# Autodesk Inventor assembly: MM0948AN140_G00_805
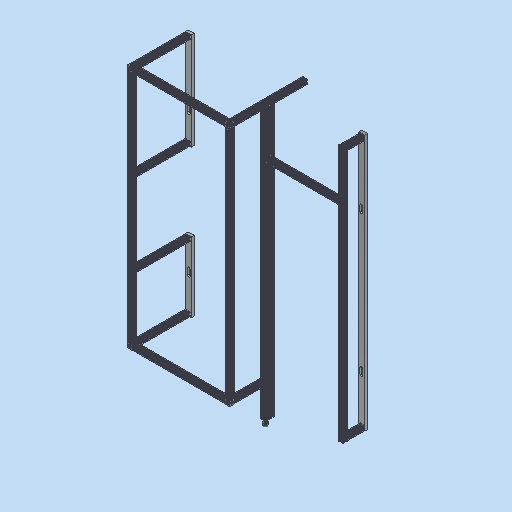
[picture p0: Inventor's stored thumbnail of the model, 512x512]
Saved by Autodesk Inventor 2023.3 (Build 273359000, 359)
## iProperties
RuleStatus: InUse
Created: 2023-03-23
Part Number: MM0948AN140_G00_805
Description: =<RBPARTNOTITLE2>
Document SubType Name: Assembly
Designer: FH/Wi
Mass: 4741.17 g
Surface Area: 15490.5 cm^2
Volume: 1790.95 cm^3
Density: 2.6473 g/cm^3
AnP_Kategorie: 98
AnP_Material: =<Material>
AnP_TemplVers: 20200821
RBDOCUMENTTYPE: DRF
RBDOCUMENTVERSION: 00
RBDRAWINGMAINSCALE: 1:1
RBDRAWINGMISSINGSPEC: --
RBDRAWINGVOLUME: --
RBDSV1: 0850
RBGBEDGESIN1: +0,5
RBGBEDGESIN2: +0,2
RBGBEDGESOUT1: -0,3
RBGBEDGESOUT2: -0,1
RBMATERIAL: =<Material>
RBMATMEETS: --
RBMATNO: =<Part Number>
RBPARTMADEOF: --
RBPARTNO: SIEHE MNR
RBPARTNOTITLE1: enter description here
RBPARTNOTITLE2: hier Bezeichnung eintragen
RBPARTSAFETYINDICATOR: --
RBSURFACE: --
RBSURFACE2: --
RBZEDGESNORM: ISO13715:2002-06
RBZGENDIMCLASS: m
RBZGENDIMNORM: ISO 2768-1:1989-11
RBZGENGEOCLASS: H
RBZGENGEONORM: ISO 2768-2:1989-11
RBZSURFACENORM: ISO13D2:2002-02
RBZTOLERANCENORM: ISO 14405-1:2010-12
Author: FH/Wi
Keywords: =<RBPARTMADEOF>
Comments: =<RBSURFACE2>
Revision Number: 01
## Documents named in this file (17)
- C:\Users\rea9an\Documents\Inventor\TCAI2412_te1910_EM\AS00000954.iam
- C:\Users\rea9an\Documents\Inventor\TCAI2412_te1910_EM\PT00004339.ipt
- C:\Users\rea9an\Documents\Inventor\TCAI2412_te1910_EM\PT00004322.ipt
- C:\Users\rea9an\Documents\Inventor\TCAI2412_te1910_EM\PT00004293.ipt
- C:\Users\rea9an\Documents\Inventor\TCAI2412_te1910_EM\PT00004351.ipt
- C:\Users\rea9an\Documents\Inventor\TCAI2412_te1910_EM\PT00004354.ipt
- C:\Users\rea9an\Documents\Inventor\TCAI2412_te1910_EM\PT00004314.ipt
- C:\Users\rea9an\Documents\Inventor\TCAI2412_te1910_EM\PT00004342.ipt
- C:\Users\rea9an\Documents\Inventor\TCAI2412_te1910_EM\PT00004353.ipt
- C:\Users\rea9an\Documents\Inventor\TCAI2412_te1910_EM\PT00004345.ipt
- C:\Users\rea9an\Documents\Inventor\TCAI2412_te1910_EM\PT00004676.ipt
- C:\Users\rea9an\Documents\Inventor\TCAI2412_te1910_EM\PT00004349.ipt
- C:\Users\rea9an\Documents\Inventor\TCAI2412_te1910_EM\PT00004677.ipt
- C:\Users\rea9an\Documents\Inventor\TCAI2412_te1910_EM\PT00004678.ipt
- C:\Users\rea9an\Documents\Inventor\TCAI2412_te1910_EM\PT00004352.ipt
- C:\Users\rea9an\Documents\Inventor\TCAI2412_te1910_EM\PT00004887.ipt
- C:\Users\rea9an\Documents\Inventor\TCAI2412_te1910_EM\PT00004346.ipt
## Components (45 placed, 16 different names)
1. PT00004676:1 — Fluchtend:83, Fluchtend:84, Fluchtend:86, Fluchtend:87, Fluchtend:94, Fluchtend:95, Einfügen:6, Einfügen:7
2. PT00004677:1 — Fluchtend:84, Fluchtend:85, Fluchtend:88, Fluchtend:89, Fluchtend:96, Fluchtend:97, Passend:58, Passend:59, Fluchtend:99, Einfügen:4, Einfügen:5
3. PT00004678:1 — Fluchtend:85, Fluchtend:90, Fluchtend:105, Einfügen:2, Einfügen:3
4. PT00004322:4 — Passend:15, Fluchtend:15, Fluchtend:47, Fluchtend:88, Fluchtend:89, Fluchtend:98
5. PT00004322:3 — Fluchtend:30, Passend:31, Fluchtend:43, Fluchtend:44
6. PT00004322:1 — Fluchtend:72
7. PT00004322:2 — Fluchtend:21, Fluchtend:22, Fluchtend:35, Fluchtend:86, Passend:56, Fluchtend:92, Fluchtend:93
8. PT00004293:1 — Passend:22, Passend:43
9. PT00004339:1 — Passend:15, Fluchtend:15, Fluchtend:21, Fluchtend:22, Fluchtend:47, Fluchtend:87, Passend:55, Passend:57
10. PT00004339:2 — Fluchtend:30
11. PT00004351:1 — Passend:31, Fluchtend:43, Fluchtend:44, Passend:42, Passend:44, Passend:45
12. PT00004353:1 — Fluchtend:73, Passend:52
13. PT00004354:1 — Passend:42, Passend:43
14. PT00004345:1 — Fluchtend:73, Fluchtend:74, Passend:52, Fluchtend:90, Fluchtend:102, Fluchtend:103, Passend:60, Fluchtend:105, Fluchtend:106, Passend:61, Fluchtend:107
15. PT00004342:1
16. PT00004349:1 — Passend:56, Fluchtend:92, Fluchtend:93
17. PT00004349:2 — Fluchtend:94, Passend:57, Fluchtend:95
18. PT00004349:3 — Fluchtend:96, Fluchtend:97, Passend:58
19. PT00004349:5 — Fluchtend:98, Passend:59, Fluchtend:99
20. PT00004346:1
21. PT00004342:2
22. PT00004352:1 — Fluchtend:102, Fluchtend:103, Passend:60
23. PT00004352:2 — Fluchtend:106, Passend:61, Fluchtend:107
24. PT00004887:1 — Einfügen:2
25. PT00004887:2 — Einfügen:3
26. PT00004887:3 — Einfügen:4
27. PT00004887:4 — Einfügen:5
28. PT00004887:5 — Einfügen:6
29. PT00004887:6 — Einfügen:7
30. PT00004314:1 — Passend:44, Passend:45
31. PT00004314:2
32. PT00004314:3
33. PT00004314:4
34. PT00004314:5
35. PT00004314:6
36. PT00004314:7
37. PT00004314:8
38. PT00004314:9
39. PT00004314:10
40. PT00004314:11
41. PT00004314:12
42. PT00004314:13
43. PT00004314:14
44. PT00004314:15
45. PT00004314:16
## Component patterns: (16 elements, first: PT00004314:1)
## Relationships (76: Flush 45, Mate 23, Insert 7, Angle 1)
- [Mate]: PT00004322:2 ↔ PT00004339:1
- [Mate]: PT00004322:1 ↔ PT00004346:1
- Passend:15 [Mate]: PT00004322:4 ↔ PT00004339:1
- Fluchtend:15 [Flush]: PT00004322:4 ↔ PT00004339:1
- [Flush]: PT00004322:1 ↔ PT00004339:2
- [Flush]: PT00004322:1 ↔ PT00004339:2
- [Mate]: PT00004322:1 ↔ PT00004339:2
- [Insert]: PT00004322:3 ↔ PT00004339:2
- [Flush]: PT00004339:1 ↔ PT00004342:1
- [Flush]: PT00004322:2 ↔ PT00004342:1
- Fluchtend:21 [Flush]: PT00004322:2 ↔ PT00004339:1
- [Mate]: PT00004322:2 ↔ PT00004342:1
- Fluchtend:22 [Flush]: PT00004322:2 ↔ PT00004339:1
- [Flush]: PT00004322:1 ↔ PT00004342:1
- [Flush]: PT00004322:1 ↔ PT00004342:1
- Fluchtend:30 [Flush]: PT00004322:3 ↔ PT00004339:2
- Passend:22 [Mate]: PT00004293:1
- [Angle] (0 deg): PT00004293:1 ↔ PT00004354:1
- [Mate] (-1855 mm): PT00004342:1
- Fluchtend:35 [Flush] (1153 mm): PT00004322:2
- [Flush]: PT00004322:4 ↔ PT00004342:2
- [Flush]: PT00004322:1 ↔ PT00004346:1
- [Flush]: PT00004322:1 ↔ PT00004346:1
- Passend:31 [Mate]: PT00004322:3 ↔ PT00004351:1
- Fluchtend:43 [Flush]: PT00004322:3 ↔ PT00004351:1
- Fluchtend:44 [Flush]: PT00004322:3 ↔ PT00004351:1
- Fluchtend:47 [Flush]: PT00004322:4 ↔ PT00004339:1
- [Mate]: PT00004322:4 ↔ PT00004342:2
- [Flush]: PT00004322:4 ↔ PT00004342:2
- [Mate] (941 mm): PT00004353:1
- [Mate]: PT00004354:1 ↔ PT00004346:1
- [Flush]: PT00004354:1 ↔ PT00004346:1
- Passend:42 [Mate]: PT00004351:1 ↔ PT00004354:1
- Passend:43 [Mate]: PT00004293:1 ↔ PT00004354:1
- Passend:44 [Mate]: PT00004351:1 ↔ PT00004314:1
- Passend:45 [Mate]: PT00004351:1 ↔ PT00004314:1
- [Flush]: PT00004353:1 ↔ PT00004354:1
- Fluchtend:72 [Flush] (51 mm): PT00004322:1
- Fluchtend:73 [Flush]: PT00004353:1 ↔ PT00004345:1
- Fluchtend:74 [Flush] (370 mm): PT00004345:1
- Passend:52 [Mate]: PT00004353:1 ↔ PT00004345:1
- Fluchtend:83 [Flush] (1605 mm): PT00004676:1
- Fluchtend:84 [Flush]: PT00004676:1 ↔ PT00004677:1
- Fluchtend:85 [Flush]: PT00004677:1 ↔ PT00004678:1
- Fluchtend:86 [Flush]: PT00004676:1 ↔ PT00004322:2
- Fluchtend:87 [Flush]: PT00004676:1 ↔ PT00004339:1
- Fluchtend:88 [Flush]: PT00004677:1 ↔ PT00004322:4
- Fluchtend:89 [Flush]: PT00004677:1 ↔ PT00004322:4
- Fluchtend:90 [Flush]: PT00004678:1 ↔ PT00004345:1
- Passend:55 [Mate] (-370 mm): PT00004339:1
- Passend:56 [Mate]: PT00004322:2 ↔ PT00004349:1
- Fluchtend:92 [Flush]: PT00004322:2 ↔ PT00004349:1
- Fluchtend:93 [Flush]: PT00004322:2 ↔ PT00004349:1
- Fluchtend:94 [Flush]: PT00004676:1 ↔ PT00004349:2
- Passend:57 [Mate]: PT00004339:1 ↔ PT00004349:2
- Fluchtend:95 [Flush]: PT00004676:1 ↔ PT00004349:2
- Fluchtend:96 [Flush]: PT00004677:1 ↔ PT00004349:3
- Fluchtend:97 [Flush]: PT00004677:1 ↔ PT00004349:3
- Passend:58 [Mate]: PT00004677:1 ↔ PT00004349:3
- Fluchtend:98 [Flush]: PT00004322:4 ↔ PT00004349:5
- Passend:59 [Mate]: PT00004677:1 ↔ PT00004349:5
- Fluchtend:99 [Flush]: PT00004677:1 ↔ PT00004349:5
- Fluchtend:102 [Flush]: PT00004345:1 ↔ PT00004352:1
- Fluchtend:103 [Flush]: PT00004345:1 ↔ PT00004352:1
- Passend:60 [Mate]: PT00004345:1 ↔ PT00004352:1
- [Flush]: PT00004345:1 ↔ PT00004346:1
- Fluchtend:105 [Flush]: PT00004678:1 ↔ PT00004345:1
- Fluchtend:106 [Flush]: PT00004345:1 ↔ PT00004352:2
- Passend:61 [Mate]: PT00004345:1 ↔ PT00004352:2
- Fluchtend:107 [Flush]: PT00004345:1 ↔ PT00004352:2
- Einfügen:2 [Insert]: PT00004678:1 ↔ PT00004887:1
- Einfügen:3 [Insert]: PT00004678:1 ↔ PT00004887:2
- Einfügen:4 [Insert]: PT00004677:1 ↔ PT00004887:3
- Einfügen:5 [Insert]: PT00004677:1 ↔ PT00004887:4
- Einfügen:6 [Insert]: PT00004676:1 ↔ PT00004887:5
- Einfügen:7 [Insert]: PT00004676:1 ↔ PT00004887:6
